# Autodesk Inventor assembly: Roller_Assembly
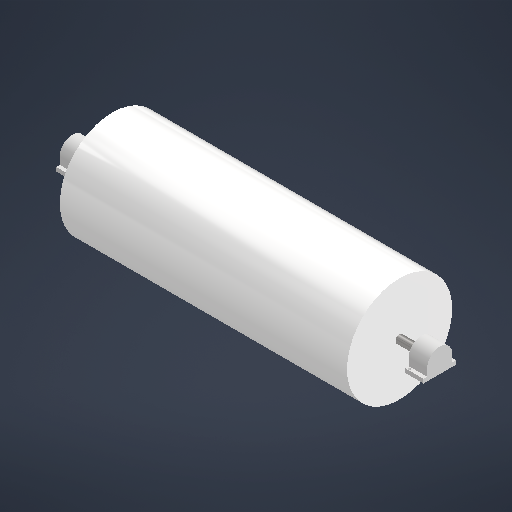
[picture p0: Inventor's stored thumbnail of the model, 512x512]
Saved by Autodesk Inventor 2026.2 (Build 302298010, 298A)
## iProperties
Created: 2026-10-11
Part Number: Roller_Assembly
Document SubType Name: Assembly
Designer: User
Author: User
## Documents named in this file (5)
- D:\Autodesk Invento Pro Work\Honours Project\Parts\Roller_Assembly.iam
- D:\Autodesk Invento Pro Work\Honours Project\Parts\Roller.ipt
- D:\Autodesk Invento Pro Work\Honours Project\Parts\Steel Rod.ipt
- D:\Autodesk Invento Pro Work\Honours Project\Parts\Axle Bearing.ipt
- D:\Autodesk Invento Pro Work\Honours Project\Parts\Roller Rod Mount.ipt
## Components (6 placed, 4 different names)
1. Roller:1 — Mate:1
2. Steel Rod:1 — Mate:1, Mate:2, Mate:3
3. Axle Bearing:1 — Mate:2, Mate:5
4. Axle Bearing:2 — Mate:3, Mate:4
5. Roller Rod Mount:1 — Mate:4
6. Roller Rod Mount:2 — Mate:5
## Relationships (5: Mate 5)
- Mate:1 (402.5 mm): Roller:1 ↔ Steel Rod:1
- Mate:2: Steel Rod:1 ↔ Axle Bearing:1
- Mate:3: Steel Rod:1 ↔ Axle Bearing:2
- Mate:4: Axle Bearing:2 ↔ Roller Rod Mount:1
- Mate:5: Axle Bearing:1 ↔ Roller Rod Mount:2
